# Autodesk Inventor assembly: 01_Ensemble
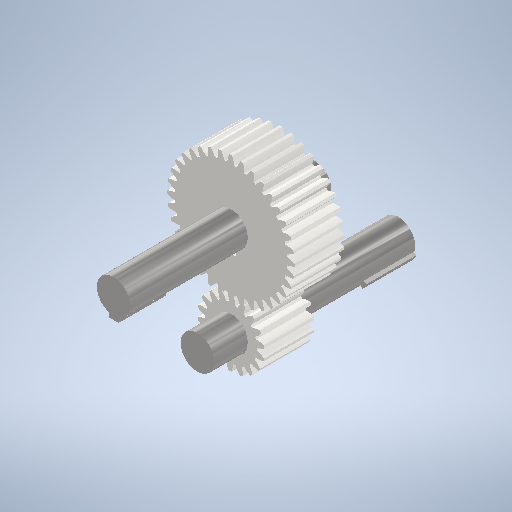
[picture p0: Inventor's stored thumbnail of the model, 512x512]
Saved by Autodesk Inventor 2025.3 (Build 293356000, 356)
## iProperties
Created: 2026-11-04
Part Number: 01_Ensemble
Document SubType Name: Assembly
Designer: hugoh
Author: hugoh
## Documents named in this file (8)
- C:\Users\hugoh\Github\Reducteur_EIM1\01_Ensemble.iam
- C:\Users\hugoh\Github\Reducteur_EIM1\01_Ensemble\Design Accelerator\Engrenages cylindriques2.iam
- C:\Users\hugoh\Github\Reducteur_EIM1\00_Arbre_entree.ipt
- C:\Users\hugoh\Github\Reducteur_EIM1\11_Squelette.ipt
- C:\Users\hugoh\Github\Reducteur_EIM1\DIN 6885-B 3x3x14.ipt
- C:\Users\hugoh\Github\Reducteur_EIM1\00_Arbre_sortie.ipt
- C:\Users\hugoh\Github\Reducteur_EIM1\DIN 6885-B 2x2x15.ipt
- C:\Users\hugoh\Github\Reducteur_EIM1\DIN 6885-B 2x2x15_CPY.ipt
## Components (8 placed, 6 different names)
1. Train engrenage 2:1 [sub-assembly] — Placage:2, Placage:3, Placage:4, Placage:5, Placage:13
2. 00_Arbre_entree:1 — Placage:1, Affleurement:1, Placage:5, Placage:6, Affleurement:2, Affleurement:3, Affleurement:4
3. 11_Squelette:1 — Placage:1, Affleurement:1, Placage:2, Placage:3, Placage:4, Placage:7, Affleurement:5, Placage:14, Placage:8, Placage:10, Placage:12
4. DIN 6885-B 3x3x14:1 — Placage:6, Placage:7, Affleurement:2
5. DIN 6885-B 3x3x14:2 — Affleurement:3, Affleurement:4, Affleurement:5
6. 00_Arbre_sortie:1 — Placage:14, Placage:8, Placage:13, Placage:18, Affleurement:18, Placage:17, Affleurement:17
7. DIN 6885-B 2x2x15:1 — Placage:18, Placage:10, Affleurement:18
8. DIN 6885-B 2x2x15:2 — Placage:17, Affleurement:17, Placage:12
## Relationships (21: Mate 14, Flush 7)
- Placage:1 [Mate]: 00_Arbre_entree:1 ↔ 11_Squelette:1
- Affleurement:1 [Flush]: 00_Arbre_entree:1 ↔ 11_Squelette:1
- Placage:2 [Mate]: Train engrenage 2:1 ↔ 11_Squelette:1
- Placage:3 [Mate]: Train engrenage 2:1 ↔ 11_Squelette:1
- Placage:4 [Mate]: Train engrenage 2:1 ↔ 11_Squelette:1
- Placage:5 [Mate]: Train engrenage 2:1 ↔ 00_Arbre_entree:1
- Placage:6 [Mate]: 00_Arbre_entree:1 ↔ DIN 6885-B 3x3x14:1
- Placage:7 [Mate]: 11_Squelette:1 ↔ DIN 6885-B 3x3x14:1
- Affleurement:2 [Flush]: 00_Arbre_entree:1 ↔ DIN 6885-B 3x3x14:1
- Affleurement:3 [Flush]: 00_Arbre_entree:1 ↔ DIN 6885-B 3x3x14:2
- Affleurement:4 [Flush]: 00_Arbre_entree:1 ↔ DIN 6885-B 3x3x14:2
- Affleurement:5 [Flush]: 11_Squelette:1 ↔ DIN 6885-B 3x3x14:2
- Placage:14 [Mate]: 11_Squelette:1 ↔ 00_Arbre_sortie:1
- Placage:8 [Mate]: 11_Squelette:1 ↔ 00_Arbre_sortie:1
- Placage:13 [Mate]: Train engrenage 2:1 ↔ 00_Arbre_sortie:1
- Placage:18 [Mate]: 00_Arbre_sortie:1 ↔ DIN 6885-B 2x2x15:1
- Placage:10 [Mate]: 11_Squelette:1 ↔ DIN 6885-B 2x2x15:1
- Affleurement:18 [Flush]: 00_Arbre_sortie:1 ↔ DIN 6885-B 2x2x15:1
- Placage:17 [Mate]: 00_Arbre_sortie:1 ↔ DIN 6885-B 2x2x15:2
- Affleurement:17 [Flush]: 00_Arbre_sortie:1 ↔ DIN 6885-B 2x2x15:2
- Placage:12 [Mate]: 11_Squelette:1 ↔ DIN 6885-B 2x2x15:2
